# Autodesk Inventor assembly: QUADRO DE COMANDOS DA PALITEIRA
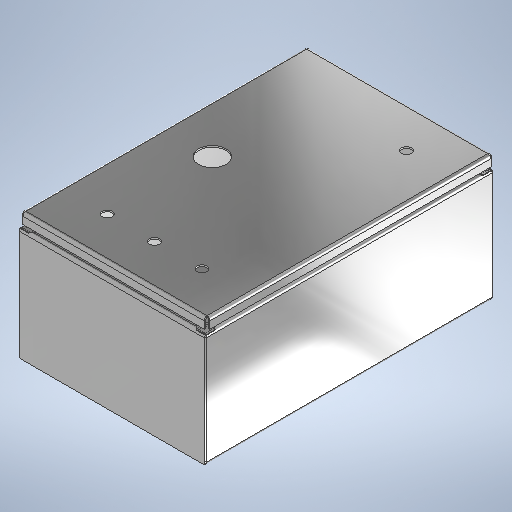
[picture p0: Inventor's stored thumbnail of the model, 512x512]
Saved by Autodesk Inventor 2025 (Build 290162000, 162)
## iProperties
Created: 2019-07-12
Part Number: QUADRO DE COMANDOS DA PALITEIRA
Document SubType Name: Assembly
Designer: CESAR
Mass: 7099.8 g
Surface Area: 14887.1 cm^2
Volume: 887.475 cm^3
Density: 8 g/cm^3
Author: CESAR
## Documents named in this file (4)
- E:\SENAI\6º Semestre\CMVI - Tony\Montagem 3D\QUADRO DE COMANDOS\QUADRO DE COMANDOS.iam
- E:\SENAI\6º Semestre\CMVI - Tony\Montagem 3D\QUADRO DE COMANDOS\CHAPA 18 DE ACO INOX-304 - CAIXA.ipt
- E:\SENAI\6º Semestre\CMVI - Tony\Montagem 3D\QUADRO DE COMANDOS\CHAPA 18 DE ACO INOX-304 - TAMPA DE FECHAMENTO DA CAIXA.ipt
- E:\SENAI\6º Semestre\CMVI - Tony\Montagem 3D\QUADRO DE COMANDOS\CHAPA 18 DE ACO INOX-304 - PORTA DA CAIXA.ipt
## Components (4 placed, 3 different names)
1. CHAPA 18 DE ACO INOX-304 - CAIXA:1 — Coincidência:1, Alinhamento:1, Coincidência:2, Coincidência:3, Alinhamento:2, Alinhamento:3, Alinhamento:6
2. CHAPA 18 DE ACO INOX-304 - TAMPA DE FECHAMENTO DA CAIXA:1 — Coincidência:1, Alinhamento:1, Alinhamento:3, Coincidência:5, Alinhamento:7
3. CHAPA 18 DE ACO INOX-304 - TAMPA DE FECHAMENTO DA CAIXA:2 — Coincidência:2, Coincidência:3, Alinhamento:2
4. CHAPA 18 DE ACO INOX-304 - PORTA DA CAIXA:1 — Coincidência:5, Alinhamento:6, Alinhamento:7
## Relationships (9: Flush 5, Mate 4)
- Coincidência:1 [Mate]: CHAPA 18 DE ACO INOX-304 - CAIXA:1 ↔ CHAPA 18 DE ACO INOX-304 - TAMPA DE FECHAMENTO DA CAIXA:1
- Alinhamento:1 [Flush]: CHAPA 18 DE ACO INOX-304 - CAIXA:1 ↔ CHAPA 18 DE ACO INOX-304 - TAMPA DE FECHAMENTO DA CAIXA:1
- Coincidência:2 [Mate]: CHAPA 18 DE ACO INOX-304 - CAIXA:1 ↔ CHAPA 18 DE ACO INOX-304 - TAMPA DE FECHAMENTO DA CAIXA:2
- Coincidência:3 [Mate]: CHAPA 18 DE ACO INOX-304 - CAIXA:1 ↔ CHAPA 18 DE ACO INOX-304 - TAMPA DE FECHAMENTO DA CAIXA:2
- Alinhamento:2 [Flush]: CHAPA 18 DE ACO INOX-304 - CAIXA:1 ↔ CHAPA 18 DE ACO INOX-304 - TAMPA DE FECHAMENTO DA CAIXA:2
- Alinhamento:3 [Flush]: CHAPA 18 DE ACO INOX-304 - CAIXA:1 ↔ CHAPA 18 DE ACO INOX-304 - TAMPA DE FECHAMENTO DA CAIXA:1
- Coincidência:5 [Mate] (1.5 mm): CHAPA 18 DE ACO INOX-304 - TAMPA DE FECHAMENTO DA CAIXA:1 ↔ CHAPA 18 DE ACO INOX-304 - PORTA DA CAIXA:1
- Alinhamento:6 [Flush]: CHAPA 18 DE ACO INOX-304 - CAIXA:1 ↔ CHAPA 18 DE ACO INOX-304 - PORTA DA CAIXA:1
- Alinhamento:7 [Flush]: CHAPA 18 DE ACO INOX-304 - TAMPA DE FECHAMENTO DA CAIXA:1 ↔ CHAPA 18 DE ACO INOX-304 - PORTA DA CAIXA:1
